# Autodesk Inventor assembly: ensamble6
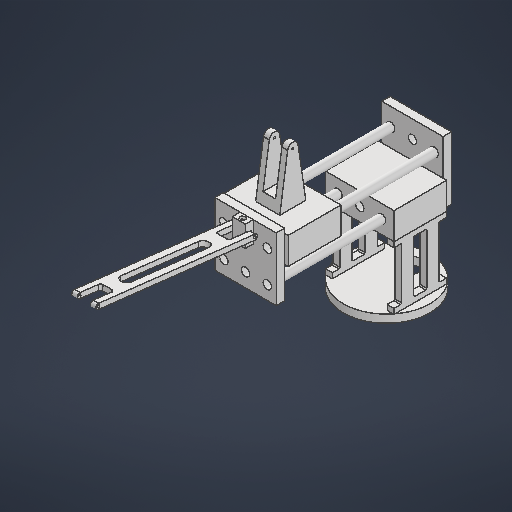
[picture p0: Inventor's stored thumbnail of the model, 512x512]
Saved by Autodesk Inventor 2027.1 (Build 311270010, 270A)
## iProperties
Created: 2026-11-07
Part Number: ensamble6
Document SubType Name: Assembly
Designer: MANGEL
Author: MANGEL
## Documents named in this file (5)
- C:\Users\MANGEL\Desktop\Brazo 4GL\ensamble6.iam
- C:\Users\MANGEL\Desktop\Brazo 4GL\ENSAMBLE2.iam
- C:\Users\MANGEL\Desktop\Brazo 4GL\baseCorredera.ipt
- C:\Users\MANGEL\Desktop\Brazo 4GL\barraBrazo1.ipt
- C:\Users\MANGEL\Desktop\Brazo 4GL\baseBrazo.ipt
## Components (5 placed, 4 different names)
1. ENSAMBLE2:1 [sub-assembly] — Coincidencia:1, Nivelación:1, Nivelación:2, Coincidencia:2, Nivelación:3, Nivelación:4, Insertar:1
2. baseCorredera:1 — Coincidencia:1, Nivelación:1, Nivelación:2, Coincidencia:3
3. baseCorredera:2 — Coincidencia:2, Nivelación:3, Nivelación:4
4. barraBrazo1:1 — Insertar:1
5. baseBrazo:1 — Coincidencia:3
## Relationships (8: Flush 4, Mate 3, Insert 1)
- Coincidencia:1 [Mate]: ENSAMBLE2:1 ↔ baseCorredera:1
- Nivelación:1 [Flush]: ENSAMBLE2:1 ↔ baseCorredera:1
- Nivelación:2 [Flush]: ENSAMBLE2:1 ↔ baseCorredera:1
- Coincidencia:2 [Mate]: ENSAMBLE2:1 ↔ baseCorredera:2
- Nivelación:3 [Flush]: ENSAMBLE2:1 ↔ baseCorredera:2
- Nivelación:4 [Flush]: ENSAMBLE2:1 ↔ baseCorredera:2
- Insertar:1: ENSAMBLE2:1 ↔ barraBrazo1:1
- Coincidencia:3 [Mate]: baseCorredera:1 ↔ baseBrazo:1
